# Autodesk Inventor assembly: Z_Oefening_Zwenkwiel
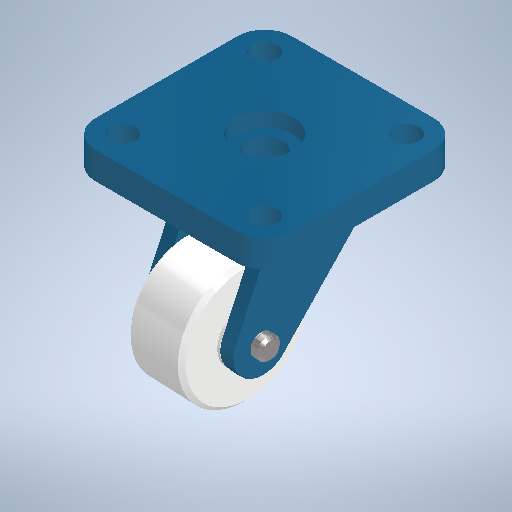
[picture p0: Inventor's stored thumbnail of the model, 512x512]
Saved by Autodesk Inventor 2025 (Build 290162000, 162)
## iProperties
Created: 2023-06-25
Part Number: Z_Oefening_Zwenkwiel
Document SubType Name: Assembly
Designer: Jeroen
Author: Jeroen
## Documents named in this file (7)
- C:\Users\ALUNO\Desktop\roda boba\VTK_02.02-Zwenkwiel.iam
- C:\Users\ALUNO\Desktop\roda boba\VTK_02.02-Zwenkwiel-Bevestigingsplaat.ipt
- C:\Users\ALUNO\Desktop\roda boba\VTK_02.02-Zwenkwiel-Beugel.ipt
- C:\Users\ALUNO\Desktop\roda boba\VTK_02.02-Zwenkwiel-Wiel.ipt
- C:\Users\ALUNO\Desktop\roda boba\VTK_02.02-Zwenkwiel-As.ipt
- C:\Users\jeroe\OneDrive\Documenten\Inventor\Content Center Files\R2023\en-US\DIN 923\DIN 923 - M10 x 5.ipt
- C:\Users\jeroe\OneDrive\Documenten\Inventor\Content Center Files\R2023\en-US\DIN 471(3)\DIN 471 - 8 x 0,8.ipt
## Components (7 placed, 6 different names)
1. VTK_02.02-Zwenkwiel-Bevestigingsplaat:1 — Alinhado:1, Inserir:1, Inserir:2
2. VTK_02.02-Zwenkwiel-Beugel:1 — Inserir:1, Inserir:3, Inserir:6
3. VTK_02.02-Zwenkwiel-Wiel:1 — Inserir:6
4. VTK_02.02-Zwenkwiel-As:1 — Inserir:3, Inserir:4, Inserir:5
5. DIN 923 M10 x 5:1 — Inserir:2
6. DIN 471 <= 9mm 8 x 0,8:1 — Inserir:5
7. DIN 471 <= 9mm 8 x 0,8:2 — Inserir:4
## Relationships (7: Insert 6, Flush 1)
- Alinhado:1 [Flush]: VTK_02.02-Zwenkwiel-Bevestigingsplaat:1
- Inserir:1 (1 mm): VTK_02.02-Zwenkwiel-Bevestigingsplaat:1 ↔ VTK_02.02-Zwenkwiel-Beugel:1
- Inserir:2: VTK_02.02-Zwenkwiel-Bevestigingsplaat:1 ↔ DIN 923 M10 x 5:1
- Inserir:3 (0.5 mm): VTK_02.02-Zwenkwiel-Beugel:1 ↔ VTK_02.02-Zwenkwiel-As:1
- Inserir:4: VTK_02.02-Zwenkwiel-As:1 ↔ DIN 471 <= 9mm 8 x 0,8:2
- Inserir:5: VTK_02.02-Zwenkwiel-As:1 ↔ DIN 471 <= 9mm 8 x 0,8:1
- Inserir:6: VTK_02.02-Zwenkwiel-Beugel:1 ↔ VTK_02.02-Zwenkwiel-Wiel:1
